# Autodesk Inventor assembly: JIS80-GLASS115-WINDOW
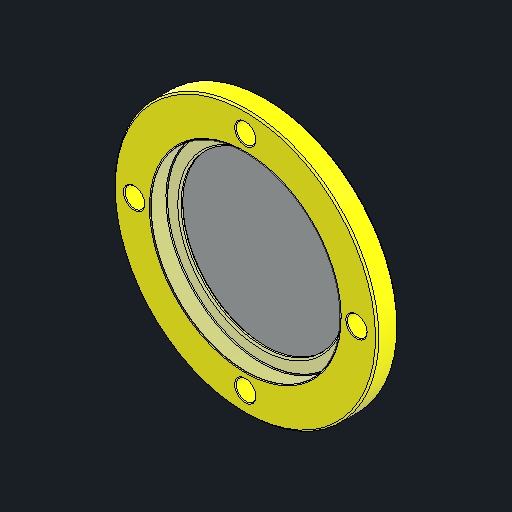
[picture p0: Inventor's stored thumbnail of the model, 512x512]
Saved by Autodesk Inventor 2027.1 (Build 311270010, 270A)
## iProperties
Created: 2025-12-12
Part Number: JIS80-GLASS115-WINDOW
Document SubType Name: Assembly
Designer: kuzmin
Author: kuzmin
## Documents named in this file (3)
- C:\Users\queezz\Dropbox\Drawings\pihti-cad\PLD\jis80-glass-115-window.iam
- C:\Users\queezz\Dropbox\Drawings\pihti-cad\PLD\glass-115-10.ipt
- C:\Users\queezz\Dropbox\Drawings\pihti-cad\PLD\jis80-glass-115-retainer.ipt
## Components (2 placed, 2 different names)
1. glass-115-10:1
2. jis80-glass-115-retainer:1
## Relationships (1: WeldJoint 1)
- [WeldJoint]: glass-115-10:1 ↔ jis80-glass-115-retainer:1
